# Autodesk Inventor assembly: PCB
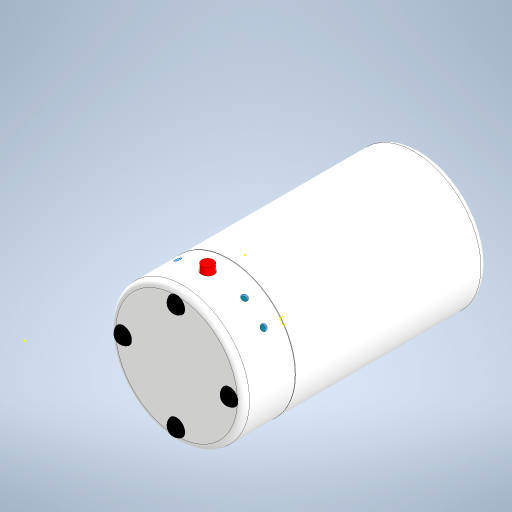
[picture p0: Inventor's stored thumbnail of the model, 512x512]
Saved by Autodesk Inventor 2024 (Build 280153000, 153)
## iProperties
Company: Open CASCADE
Created: 2026-03-24
Part Number: PCB
Description: Open CASCADE Model
Document SubType Name: Assembly
Designer: Pavel
Authority: Unknown
Sending System: Open CASCADE 7.5
Preprocessor: Open CASCADE STEP processor 7.5
Title: Open CASCADE Shape Model
Author: Author
## Documents named in this file (66)
- C:\!USER DATA\Projects\lampa\Altium part\NEO_LAMP\PCB_v1\PCB_v1.iam
- C:\!USER DATA\Projects\lampa\Altium part\NEO_LAMP\PCB_v1\Board.iam
- C:\!USER DATA\Projects\lampa\Altium part\NEO_LAMP\PCB_v1\R15.iam
- C:\!USER DATA\Projects\lampa\Altium part\NEO_LAMP\PCB_v1\XS1.iam
- C:\!USER DATA\Projects\lampa\Altium part\NEO_LAMP\PCB_v1\VT2.iam
- C:\!USER DATA\Projects\lampa\Altium part\NEO_LAMP\PCB_v1\VT1.iam
- C:\!USER DATA\Projects\lampa\Altium part\NEO_LAMP\PCB_v1\VD7.iam
- C:\!USER DATA\Projects\lampa\Altium part\NEO_LAMP\PCB_v1\VD6.iam
- C:\!USER DATA\Projects\lampa\Altium part\NEO_LAMP\PCB_v1\VD5.iam
- C:\!USER DATA\Projects\lampa\Altium part\NEO_LAMP\PCB_v1\VD4.iam
- C:\!USER DATA\Projects\lampa\Altium part\NEO_LAMP\PCB_v1\VD3.iam
- C:\!USER DATA\Projects\lampa\Altium part\NEO_LAMP\PCB_v1\VD2.iam
- C:\!USER DATA\Projects\lampa\Altium part\NEO_LAMP\PCB_v1\VD1.iam
- C:\!USER DATA\Projects\lampa\Altium part\NEO_LAMP\PCB_v1\SB1.iam
- C:\!USER DATA\Projects\lampa\Altium part\NEO_LAMP\PCB_v1\R22.iam
- C:\!USER DATA\Projects\lampa\Altium part\NEO_LAMP\PCB_v1\R21.iam
- C:\!USER DATA\Projects\lampa\Altium part\NEO_LAMP\PCB_v1\R20.iam
- C:\!USER DATA\Projects\lampa\Altium part\NEO_LAMP\PCB_v1\R19.iam
- C:\!USER DATA\Projects\lampa\Altium part\NEO_LAMP\PCB_v1\R18.iam
- C:\!USER DATA\Projects\lampa\Altium part\NEO_LAMP\PCB_v1\R17.iam
- C:\!USER DATA\Projects\lampa\Altium part\NEO_LAMP\PCB_v1\R16.iam
- C:\!USER DATA\Projects\lampa\Altium part\NEO_LAMP\PCB_v1\R14.iam
- C:\!USER DATA\Projects\lampa\Altium part\NEO_LAMP\PCB_v1\R13.iam
- C:\!USER DATA\Projects\lampa\Altium part\NEO_LAMP\PCB_v1\R12.iam
- C:\!USER DATA\Projects\lampa\Altium part\NEO_LAMP\PCB_v1\R11.iam
- C:\!USER DATA\Projects\lampa\Altium part\NEO_LAMP\PCB_v1\R10.iam
- C:\!USER DATA\Projects\lampa\Altium part\NEO_LAMP\PCB_v1\R9.iam
- C:\!USER DATA\Projects\lampa\Altium part\NEO_LAMP\PCB_v1\R8.iam
- C:\!USER DATA\Projects\lampa\Altium part\NEO_LAMP\PCB_v1\R7.iam
- C:\!USER DATA\Projects\lampa\Altium part\NEO_LAMP\PCB_v1\R6.iam
- C:\!USER DATA\Projects\lampa\Altium part\NEO_LAMP\PCB_v1\R5.iam
- C:\!USER DATA\Projects\lampa\Altium part\NEO_LAMP\PCB_v1\R4.iam
- C:\!USER DATA\Projects\lampa\Altium part\NEO_LAMP\PCB_v1\R3.iam
- C:\!USER DATA\Projects\lampa\Altium part\NEO_LAMP\PCB_v1\R2.iam
- C:\!USER DATA\Projects\lampa\Altium part\NEO_LAMP\PCB_v1\R1.iam
- C:\!USER DATA\Projects\lampa\Altium part\NEO_LAMP\PCB_v1\L1.iam
- C:\!USER DATA\Projects\lampa\Altium part\NEO_LAMP\PCB_v1\DD1.iam
- C:\!USER DATA\Projects\lampa\Altium part\NEO_LAMP\PCB_v1\DA4.iam
- C:\!USER DATA\Projects\lampa\Altium part\NEO_LAMP\PCB_v1\DA3.iam
- C:\!USER DATA\Projects\lampa\Altium part\NEO_LAMP\PCB_v1\DA2.iam
- C:\!USER DATA\Projects\lampa\Altium part\NEO_LAMP\PCB_v1\DA1.iam
- C:\!USER DATA\Projects\lampa\Altium part\NEO_LAMP\PCB_v1\C20.iam
- C:\!USER DATA\Projects\lampa\Altium part\NEO_LAMP\PCB_v1\C19.iam
- C:\!USER DATA\Projects\lampa\Altium part\NEO_LAMP\PCB_v1\C18.iam
- C:\!USER DATA\Projects\lampa\Altium part\NEO_LAMP\PCB_v1\C17.iam
- C:\!USER DATA\Projects\lampa\Altium part\NEO_LAMP\PCB_v1\C16.iam
- C:\!USER DATA\Projects\lampa\Altium part\NEO_LAMP\PCB_v1\C15.iam
- C:\!USER DATA\Projects\lampa\Altium part\NEO_LAMP\PCB_v1\C14.iam
- C:\!USER DATA\Projects\lampa\Altium part\NEO_LAMP\PCB_v1\C13.iam
- C:\!USER DATA\Projects\lampa\Altium part\NEO_LAMP\PCB_v1\C12.iam
- C:\!USER DATA\Projects\lampa\Altium part\NEO_LAMP\PCB_v1\C11.iam
- C:\!USER DATA\Projects\lampa\Altium part\NEO_LAMP\PCB_v1\C10.iam
- C:\!USER DATA\Projects\lampa\Altium part\NEO_LAMP\PCB_v1\C9.iam
- C:\!USER DATA\Projects\lampa\Altium part\NEO_LAMP\PCB_v1\C7.iam
- C:\!USER DATA\Projects\lampa\Altium part\NEO_LAMP\PCB_v1\C6.iam
- C:\!USER DATA\Projects\lampa\Altium part\NEO_LAMP\PCB_v1\C5.iam
- C:\!USER DATA\Projects\lampa\Altium part\NEO_LAMP\PCB_v1\C4.iam
- C:\!USER DATA\Projects\lampa\Altium part\NEO_LAMP\PCB_v1\C3.iam
- C:\!USER DATA\Projects\lampa\Altium part\NEO_LAMP\PCB_v1\C2.iam
- C:\!USER DATA\Projects\lampa\Altium part\NEO_LAMP\PCB_v1\C1.iam
- C:\!USER DATA\Projects\lampa\Детали\Основание.ipt
- C:\!USER DATA\Projects\lampa\Детали\Рассеиватель.ipt
- C:\!USER DATA\Projects\lampa\Детали\толкатель.ipt
- C:\!USER DATA\Projects\lampa\Детали\Световод.ipt
- C:\!USER DATA\Projects\lampa\Детали\Ножка.ipt
- C:\Users\Pavel\Documents\Inventor\Content Center Files\R2024\ru-RU\GB 6560-86\Screw GB 6560-86 M2 x 6.ipt
## Components (71 placed, 65 different names)
1. Board_2 [sub-assembly] — Заподлицо:3, Заподлицо:7, Заподлицо:8, Вставка:1, Вставка:2
2. R15_9 [sub-assembly]
3. XS1_11 [sub-assembly] — Заподлицо:1
4. VT2_18 [sub-assembly]
5. VT1_25 [sub-assembly]
6. VD7_27 [sub-assembly]
7. VD6_29 [sub-assembly]
8. VD5_31 [sub-assembly]
9. VD4_33 [sub-assembly]
10. VD3_35 [sub-assembly] — Заподлицо:6
11. VD2_37 [sub-assembly] — Заподлицо:5
12. VD1_39 [sub-assembly] — Заподлицо:4
13. SB1_48 [sub-assembly] — Заподлицо:2
14. R22_55 [sub-assembly]
15. R21_62 [sub-assembly]
16. R20_69 [sub-assembly]
17. R19_71 [sub-assembly]
18. R18_73 [sub-assembly]
19. R17_75 [sub-assembly]
20. R16_77 [sub-assembly]
21. R14_79 [sub-assembly]
22. R13_81 [sub-assembly]
23. R12_88 [sub-assembly]
24. R11_90 [sub-assembly]
25. R10_97 [sub-assembly]
26. R9_99 [sub-assembly]
27. R8_101 [sub-assembly]
28. R7_103 [sub-assembly]
29. R6_105 [sub-assembly]
30. R5_112 [sub-assembly]
31. R4_114 [sub-assembly]
32. R3_116 [sub-assembly]
33. R2_123 [sub-assembly]
34. R1_125 [sub-assembly]
35. L1_127 [sub-assembly]
36. DD1_163 [sub-assembly]
37. DA4_165 [sub-assembly]
38. DA3_167 [sub-assembly]
39. DA2_169 [sub-assembly]
40. DA1_179 [sub-assembly]
41. C20_186 [sub-assembly]
42. C19_188 [sub-assembly]
43. C18_195 [sub-assembly]
44. C17_199 [sub-assembly]
45. C16_201 [sub-assembly]
46. C15_208 [sub-assembly]
47. C14_210 [sub-assembly]
48. C13_212 [sub-assembly]
49. C12_219 [sub-assembly]
50. C11_221 [sub-assembly]
51. C10_223 [sub-assembly]
52. C9_225 [sub-assembly]
53. C7_227 [sub-assembly]
54. C6_229 [sub-assembly]
55. C5_236 [sub-assembly]
56. C4_238 [sub-assembly] — Совмещение:1
57. C3_240 [sub-assembly]
58. C2_247 [sub-assembly] — Совмещение:2
59. C1_249 [sub-assembly]
60. Основание:1 — Заподлицо:1, Заподлицо:2, Заподлицо:3, Заподлицо:4, Заподлицо:5, Заподлицо:6, Заподлицо:7, Заподлицо:8, Заподлицо:9, Заподлицо:11, Жесткий:1, Жесткий:2, Жесткий:3, Жесткий:4, Совмещение:4, Совмещение:5, Совмещение:6, Совмещение:7
61. Рассеиватель:1 — Заподлицо:9, Заподлицо:11, Совмещение:3
62. толкатель:1 — Жесткий:1
63. Световод:1 — Жесткий:2
64. Световод:2 — Жесткий:3
65. Световод:3 — Жесткий:4
66. Ножка:1 — Совмещение:4
67. Ножка:2 — Совмещение:5
68. Ножка:3 — Совмещение:7
69. Ножка:4 — Совмещение:6
70. Tapping screw GB/T 6560-1986 M2x6:1 — Вставка:1
71. Tapping screw GB/T 6560-1986 M2x6:2 — Вставка:2
## Relationships (23: Flush 10, Mate 7, WeldJoint 4, Insert 2)
- Заподлицо:1 [Flush] (25.4 mm): XS1_11 ↔ Основание:1
- Заподлицо:2 [Flush] (10 mm): SB1_48 ↔ Основание:1
- Заподлицо:3 [Flush]: Board_2 ↔ Основание:1
- Заподлицо:4 [Flush]: VD1_39 ↔ Основание:1
- Заподлицо:5 [Flush] (10 mm): VD2_37 ↔ Основание:1
- Заподлицо:6 [Flush] (10 mm): VD3_35 ↔ Основание:1
- Заподлицо:7 [Flush]: Board_2 ↔ Основание:1
- Заподлицо:8 [Flush]: Board_2 ↔ Основание:1
- Заподлицо:9 [Flush]: Основание:1 ↔ Рассеиватель:1
- Заподлицо:11 [Flush] (0.2 mm): Основание:1 ↔ Рассеиватель:1
- Жесткий:1 [WeldJoint] (-3.3 mm): Основание:1 ↔ толкатель:1
- Жесткий:2 [WeldJoint] (-2 mm): Основание:1 ↔ Световод:1
- Жесткий:3 [WeldJoint]: Основание:1 ↔ Световод:2
- Жесткий:4 [WeldJoint]: Основание:1 ↔ Световод:3
- Совмещение:1 [Mate]: C4_238
- Совмещение:2 [Mate]: C2_247
- Совмещение:3 [Mate]: Рассеиватель:1
- Совмещение:4 [Mate]: Основание:1 ↔ Ножка:1
- Совмещение:5 [Mate]: Основание:1 ↔ Ножка:2
- Совмещение:6 [Mate]: Основание:1 ↔ Ножка:4
- Совмещение:7 [Mate]: Основание:1 ↔ Ножка:3
- Вставка:1 [Insert]: Board_2 ↔ Tapping screw GB/T 6560-1986 M2x6:1
- Вставка:2 [Insert]: Board_2 ↔ Tapping screw GB/T 6560-1986 M2x6:2
